# Autodesk Inventor assembly: Camel Pedestrian
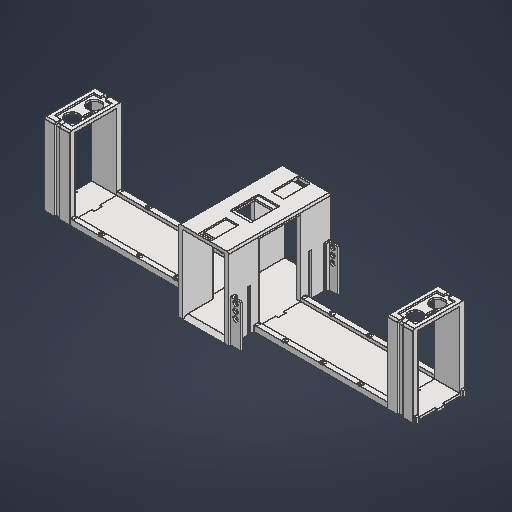
[picture p0: Inventor's stored thumbnail of the model, 512x512]
Saved by Autodesk Inventor 2026.4 (Build 304435000, 435)
## iProperties
Created: 2026-10-05
Part Number: Camel Pedestrian
Document SubType Name: Assembly
Designer: LENOVO
Author: LENOVO
## Documents named in this file (6)
- C:\Users\LENOVO\OneDrive - ACTVET (Abu Dhabi Center for Technical and Vocational Education and Training)\99-Projects\claude\Camel Pedestrian\3d\Camel Pedestrian.iam
- C:\Users\LENOVO\OneDrive - ACTVET (Abu Dhabi Center for Technical and Vocational Education and Training)\99-Projects\claude\Camel Pedestrian\3d\Camel Gate.ipt
- C:\Users\LENOVO\OneDrive - ACTVET (Abu Dhabi Center for Technical and Vocational Education and Training)\99-Projects\claude\Camel Pedestrian\3d\road.ipt
- C:\Users\LENOVO\OneDrive - ACTVET (Abu Dhabi Center for Technical and Vocational Education and Training)\99-Projects\claude\Camel Pedestrian\3d\Car Sensor Gate.ipt
- C:\Users\LENOVO\OneDrive - ACTVET (Abu Dhabi Center for Technical and Vocational Education and Training)\99-Projects\claude\Camel Pedestrian\3d\Trafic LED.ipt
- C:\Users\LENOVO\OneDrive - ACTVET (Abu Dhabi Center for Technical and Vocational Education and Training)\99-Projects\claude\Camel Pedestrian\3d\Trafic LED_MIR.ipt
## Components (7 placed, 5 different names)
1. Camel Gate:1 — Mate:1, Mate:2, Flush:1, Flush:2, Mate:5
2. road:1 — Mate:1, Flush:2, Mate:4, Flush:3, Flush:6, Flush:7, Mate:5, Flush:9, Flush:10, Flush:11, Flush:12, Flush:13
3. road:2 — Mate:2, Flush:1, Mate:3, Flush:4, Flush:5, Flush:7, Flush:8
4. Car Sensor Gate:1 — Mate:4, Flush:3, Flush:6
5. Car Sensor Gate:2 — Mate:3, Flush:4, Flush:5
6. Trafic LED:1 — Flush:8, Flush:9, Flush:10
7. Trafic LED_MIR:1 — Flush:11, Flush:12, Flush:13
## Relationships (18: Flush 13, Mate 5)
- Mate:1: Camel Gate:1 ↔ road:1
- Mate:2: Camel Gate:1 ↔ road:2
- Flush:1: Camel Gate:1 ↔ road:2
- Flush:2: Camel Gate:1 ↔ road:1
- Mate:3: road:2 ↔ Car Sensor Gate:2
- Mate:4: road:1 ↔ Car Sensor Gate:1
- Flush:3: road:1 ↔ Car Sensor Gate:1
- Flush:4: road:2 ↔ Car Sensor Gate:2
- Flush:5: road:2 ↔ Car Sensor Gate:2
- Flush:6: road:1 ↔ Car Sensor Gate:1
- Flush:7: road:1 ↔ road:2
- Mate:5: Camel Gate:1 ↔ road:1
- Flush:8: road:2 ↔ Trafic LED:1
- Flush:9: road:1 ↔ Trafic LED:1
- Flush:10 (28 mm): road:1 ↔ Trafic LED:1
- Flush:11: road:1 ↔ Trafic LED_MIR:1
- Flush:12: road:1 ↔ Trafic LED_MIR:1
- Flush:13 (-28 mm): road:1 ↔ Trafic LED_MIR:1
